# Autodesk Inventor assembly: Jam Penyelamat
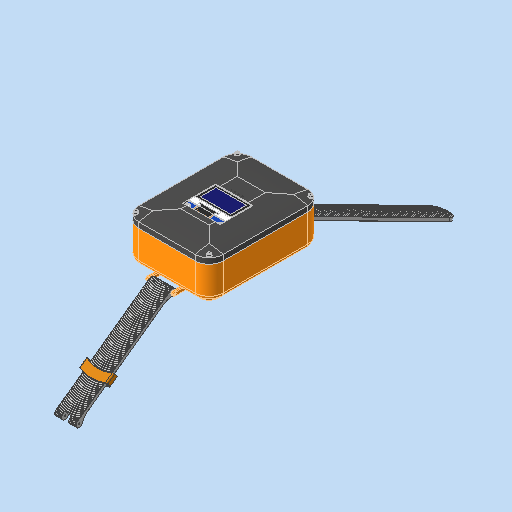
[picture p0: Inventor's stored thumbnail of the model, 512x512]
Saved by Autodesk Inventor 2026.2 (Build 302298010, 298A)
## iProperties
Created: 2026-05-23
Part Number: Jam Penyelamat
Document SubType Name: Assembly
Designer: HYLMI ATHA N
Author: HYLMI ATHA N
## Documents named in this file (14)
- D:\Belajar\Semester 4\Asistensi Arek-arek\Raihan PTE\Jam Penyelamat.iam
- D:\Belajar\Semester 4\Asistensi Arek-arek\Raihan PTE\MAX30105\MAX30105\MAX30105.ipt
- D:\Belajar\Semester 4\Asistensi Arek-arek\Raihan PTE\SHT31\SHT31\SHT31.ipt
- D:\Belajar\Semester 4\Asistensi Arek-arek\Raihan PTE\TP4056_Charging_Module_Type_C\TP4056_Charging_Module_Type_C\TP4056_Charging_Module_Type_C.iam
- D:\Belajar\Semester 4\Asistensi Arek-arek\Raihan PTE\OLED-128x64-0.96\OLED-128x64-0.96\OLED-128x64-0.96.ipt
- D:\Belajar\Semester 4\Asistensi Arek-arek\Raihan PTE\LoRa SX1278\LoRa SX1278\LoRa SX1278.ipt
- D:\Belajar\Semester 4\Asistensi Arek-arek\Raihan PTE\bmi160 v1\bmi160 v1\bmi160 v1.ipt
- D:\Belajar\Semester 4\Asistensi Arek-arek\Raihan PTE\blackpill v2.0 no_swi\blackpill v2.0 no_swi\blackpill v2.0 no_swi_TOP.iam
- D:\Belajar\Semester 4\Asistensi Arek-arek\Raihan PTE\Baterai Lipo 30x40mm\Baterai Lipo 30x40mm\Baterai Lipo 30x40mm.ipt
- D:\Belajar\Semester 4\Asistensi Arek-arek\Raihan PTE\PCB Prototype Development Board, 6x8 cm\PCB Prototype Development Board, 6x8 cm\PCB Prototype Development Board, 6x8 cm.ipt
- D:\Belajar\Semester 4\Asistensi Arek-arek\Raihan PTE\Cover\Cover Bawah.ipt
- D:\Belajar\Semester 4\Asistensi Arek-arek\Raihan PTE\Cover\Cover Atas.ipt
- D:\Belajar\Semester 4\Asistensi Arek-arek\Raihan PTE\GELANG JAM\GELANG JAM\Strap 1.ipt
- D:\Belajar\Semester 4\Asistensi Arek-arek\Raihan PTE\GELANG JAM\GELANG JAM\Part49.ipt
## Components (13 placed, 13 different names)
1. MAX30105:2 — Mate:11, Flush:16, Flush:17
2. SHT31:1 — Mate:3, Mate:11, Flush:16, Flush:17, Flush:28, Flush:29
3. TP4056_Charging_Module_Type_C:1 [sub-assembly] — Mate:8, Flush:12, Flush:13, Mate:9
4. OLED-128x64-0.96:1 — Mate:9, Flush:18, Flush:19
5. LoRa SX1278:1 — Mate:5, Flush:23, Flush:24, Mate:12, Flush:25, Flush:26
6. bmi160 v1:1 — Mate:4, Flush:21, Flush:22
7. blackpill v2.0 no_swi_TOP:1 [sub-assembly] — Mate:7, Mate:12, Flush:25, Flush:26, Flush:27
8. Baterai Lipo 30x40mm:1 — Mate:7, Mate:8, Flush:12, Flush:13, Flush:27
9. PCB Prototype Development Board, 6x8 cm:1 — Mate:1, Mate:2, Flush:1, Mate:3, Mate:4, Mate:5, Flush:20, Flush:21, Flush:22, Flush:23, Flush:24, Flush:28, Flush:29
10. Cover Bawah:1 — Flush:20, Flush:30, Mate:13, Mate:14, Mate:15, Mate:16
11. Cover Atas:1 — Flush:30
12. Strap 1:1 — Mate:13, Mate:14
13. Part49:2 — Mate:15, Mate:16
## Relationships (32: Flush 18, Mate 14)
- Mate:1: PCB Prototype Development Board, 6x8 cm:1
- Mate:2: PCB Prototype Development Board, 6x8 cm:1
- Flush:1: PCB Prototype Development Board, 6x8 cm:1
- Mate:3: SHT31:1 ↔ PCB Prototype Development Board, 6x8 cm:1
- Mate:4: bmi160 v1:1 ↔ PCB Prototype Development Board, 6x8 cm:1
- Mate:5: LoRa SX1278:1 ↔ PCB Prototype Development Board, 6x8 cm:1
- Mate:7: blackpill v2.0 no_swi_TOP:1 ↔ Baterai Lipo 30x40mm:1
- Mate:8: TP4056_Charging_Module_Type_C:1 ↔ Baterai Lipo 30x40mm:1
- Flush:12: TP4056_Charging_Module_Type_C:1 ↔ Baterai Lipo 30x40mm:1
- Flush:13: TP4056_Charging_Module_Type_C:1 ↔ Baterai Lipo 30x40mm:1
- Mate:9: TP4056_Charging_Module_Type_C:1 ↔ OLED-128x64-0.96:1
- Mate:11: MAX30105:2 ↔ SHT31:1
- Flush:16 (-3 mm): MAX30105:2 ↔ SHT31:1
- Flush:17 (-1 mm): MAX30105:2 ↔ SHT31:1
- Flush:18: OLED-128x64-0.96:1
- Flush:19: OLED-128x64-0.96:1
- Flush:20: PCB Prototype Development Board, 6x8 cm:1 ↔ Cover Bawah:1
- Flush:21 (10 mm): bmi160 v1:1 ↔ PCB Prototype Development Board, 6x8 cm:1
- Flush:22 (-5 mm): bmi160 v1:1 ↔ PCB Prototype Development Board, 6x8 cm:1
- Flush:23 (5 mm): LoRa SX1278:1 ↔ PCB Prototype Development Board, 6x8 cm:1
- Flush:24 (5 mm): LoRa SX1278:1 ↔ PCB Prototype Development Board, 6x8 cm:1
- Mate:12 (1 mm): LoRa SX1278:1 ↔ blackpill v2.0 no_swi_TOP:1
- Flush:25: LoRa SX1278:1 ↔ blackpill v2.0 no_swi_TOP:1
- Flush:26 (1 mm): LoRa SX1278:1 ↔ blackpill v2.0 no_swi_TOP:1
- Flush:27 (3 mm): blackpill v2.0 no_swi_TOP:1 ↔ Baterai Lipo 30x40mm:1
- Flush:28 (-20 mm): SHT31:1 ↔ PCB Prototype Development Board, 6x8 cm:1
- Flush:29 (20 mm): SHT31:1 ↔ PCB Prototype Development Board, 6x8 cm:1
- Flush:30: Cover Bawah:1 ↔ Cover Atas:1
- Mate:13: Cover Bawah:1 ↔ Strap 1:1
- Mate:14 (0.5 mm): Cover Bawah:1 ↔ Strap 1:1
- Mate:15: Cover Bawah:1 ↔ Part49:2
- Mate:16: Cover Bawah:1 ↔ Part49:2
